# Autodesk Inventor assembly: KSTI-MUV ASSEM
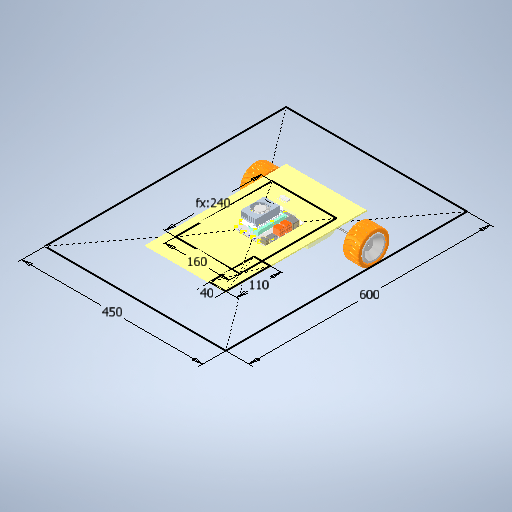
[picture p0: Inventor's stored thumbnail of the model, 512x512]
Saved by Autodesk Inventor 2026.3 (Build 303398000, 398)
## iProperties
Created: 2026-10-19
Part Number: KSTI-MUV ASSEM
Document SubType Name: Assembly
Designer: Salim
Author: Salim
## Documents named in this file (7)
- C:\Users\Salim\OneDrive - Universitas Negeri Malang\!! MIZURO\!!!!!!!!KSTI 2026\mizuro-ksti2026-muv\mechanical\3d design\KSTI-MUV ASSEM.iam
- C:\Users\Salim\OneDrive - Universitas Negeri Malang\!! MIZURO\KIDN 2025\BATERAI 3S 5000MAH.ipt
- C:\Users\Salim\OneDrive - Universitas Negeri Malang\!! MIZURO\!!!!!!!!KSTI 2026\mizuro-ksti2026-muv\mechanical\3d design\JETSON ORIN NANO\P3766-P3768SKU4-P3767ENVELOPE.iam
- C:\Users\Salim\OneDrive - Universitas Negeri Malang\!! MIZURO\!!!!!!!!KSTI 2026\mizuro-ksti2026-muv\mechanical\3d design\CHASSIS PLATE.ipt
- C:\Users\Salim\OneDrive - Universitas Negeri Malang\!! MIZURO\!!!!!!!!KSTI 2026\mizuro-ksti2026-muv\mechanical\3d design\WHEEL RIM.ipt
- C:\Users\Salim\OneDrive - Universitas Negeri Malang\!! MIZURO\!!!!!!!!KSTI 2026\mizuro-ksti2026-muv\mechanical\3d design\WHEEL TIRE.ipt
- C:\Users\Salim\OneDrive - Universitas Negeri Malang\!! MIZURO\!!!!!!!!KSTI 2026\mizuro-ksti2026-muv\mechanical\3d design\DIFF ASSEM.iam
## Components (8 placed, 6 different names)
1. BATERAI 3S 5000MAH:1
2. P3766-P3768SKU4-P3767ENVELOPE:1 [sub-assembly]
3. CHASSIS PLATE:1 — Rigid:5
4. WHEEL RIM:1 — Rigid:1, Rigid:4
5. WHEEL TIRE:1 — Rigid:1
6. DIFF ASSEM:1 [sub-assembly] — Rigid:4, Rotational:4, Rigid:5
7. WHEEL TIRE:2 — Rigid:2
8. WHEEL RIM:2 — Rigid:2, Rotational:4
## Relationships (5: WeldJoint 4, RevoluteJoint 1)
- Rigid:1 [WeldJoint]: WHEEL RIM:1 ↔ WHEEL TIRE:1
- Rigid:2 [WeldJoint]: WHEEL TIRE:2 ↔ WHEEL RIM:2
- Rigid:4 [WeldJoint]: WHEEL RIM:1 ↔ DIFF ASSEM:1
- Rotational:4 [RevoluteJoint]: DIFF ASSEM:1 ↔ WHEEL RIM:2
- Rigid:5 [WeldJoint]: CHASSIS PLATE:1 ↔ DIFF ASSEM:1
